# Autodesk Inventor assembly: motor_motando
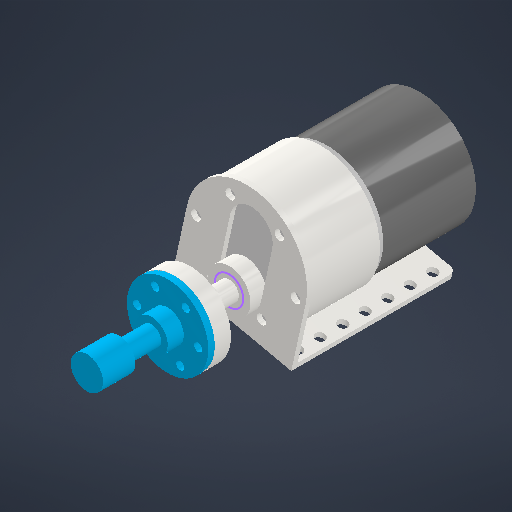
[picture p0: Inventor's stored thumbnail of the model, 512x512]
Saved by Autodesk Inventor 2026 (Build 300175000, 175)
## iProperties
Created: 2025-04-24
Part Number: motor_motando
Document SubType Name: Assembly
Designer: MARIA
Author: MARIA
## Documents named in this file (7)
- D:\maria\estudo\usp\7_semestre\pi7\mecanica\inventor\motor\motor_motando.iam
- D:\maria\estudo\usp\7_semestre\pi7\mecanica\inventor\motor\suporte_L_motor.ipt
- D:\maria\estudo\usp\7_semestre\pi7\mecanica\inventor\motor\motor.ipt
- D:\maria\estudo\usp\7_semestre\pi7\mecanica\inventor\motor\eixo_motor.ipt
- D:\maria\estudo\usp\7_semestre\pi7\mecanica\inventor\motor\saida_motor.ipt
- D:\maria\estudo\usp\7_semestre\pi7\mecanica\inventor\motor\cubo_e_eixo.ipt
- D:\maria\estudo\usp\7_semestre\pi7\mecanica\inventor\motor\carretel.ipt
## Components (6 placed, 6 different names)
1. suporte_L_motor:1 — Coincidente:1, Tangente:1, Alinhado:1, Coincidente:2
2. motor:1 — Coincidente:1, Tangente:1
3. saida_motor:1 — Alinhado:1, Coincidente:2, Alinhado:2, Inserir:1
4. eixo_motor:1 — Alinhado:2, Inserir:1, Alinhado:3, Inserir:2
5. cubo_e_eixo:1 — Alinhado:3, Inserir:2, Coincidente:3, Coincidente:4, Coincidente:5
6. carretel:1 — Coincidente:3, Coincidente:4, Coincidente:5
## Relationships (11: Mate 5, Flush 3, Insert 2, Tangent 1)
- Coincidente:1 [Mate]: suporte_L_motor:1 ↔ motor:1
- Tangente:1: suporte_L_motor:1 ↔ motor:1
- Alinhado:1 [Flush]: suporte_L_motor:1 ↔ saida_motor:1
- Coincidente:2 [Mate]: suporte_L_motor:1 ↔ saida_motor:1
- Alinhado:2 [Flush]: saida_motor:1 ↔ eixo_motor:1
- Inserir:1: saida_motor:1 ↔ eixo_motor:1
- Alinhado:3 [Flush]: eixo_motor:1 ↔ cubo_e_eixo:1
- Inserir:2: eixo_motor:1 ↔ cubo_e_eixo:1
- Coincidente:3 [Mate]: cubo_e_eixo:1 ↔ carretel:1
- Coincidente:4 [Mate]: cubo_e_eixo:1 ↔ carretel:1
- Coincidente:5 [Mate]: cubo_e_eixo:1 ↔ carretel:1
